# Autodesk Inventor assembly: ROBOT_FISH_2
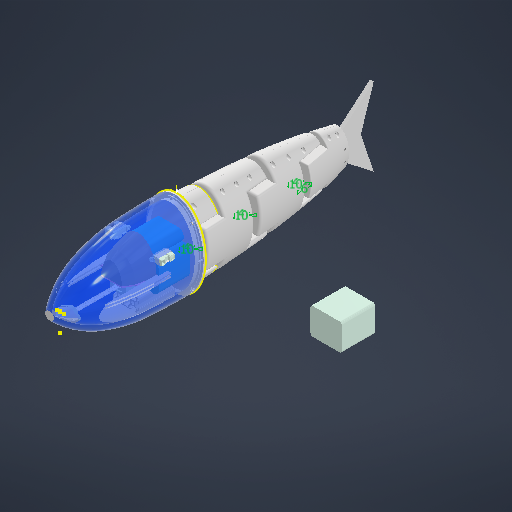
[picture p0: Inventor's stored thumbnail of the model, 512x512]
Saved by Autodesk Inventor 2027 (Build 310192060, 192F)
## iProperties
Created: 2026-04-03
Part Number: ROBOT_FISH_2
Document SubType Name: Assembly
Designer: thita
Author: thita
## Documents named in this file (19)
- D:\Year2\đồ án tốt nghịp\1\Workgroups\NotInProject\ROBOT_FISH_2.iam
- D:\Year2\đồ án tốt nghịp\1\Workgroups\NotInProject\Solid10.ipt
- D:\Year2\đồ án tốt nghịp\1\Workgroups\NotInProject\Solid12.ipt
- D:\Year2\đồ án tốt nghịp\1\Workgroups\NotInProject\Solid14.ipt
- D:\Year2\đồ án tốt nghịp\1\Workgroups\NotInProject\Hop_co_servo.iam
- D:\Year2\đồ án tốt nghịp\1\Workgroups\NotInProject\truc_khop_1_MIR.ipt
- D:\Year2\đồ án tốt nghịp\1\Workgroups\NotInProject\truc_khop2_MIR.ipt
- D:\Year2\đồ án tốt nghịp\1\Workgroups\NotInProject\truc_khop_3_MIR.ipt
- D:\Year2\đồ án tốt nghịp\1\Workgroups\NotInProject\NotInProject\NAP.ipt
- D:\Year2\đồ án tốt nghịp\1\Workgroups\NotInProject\Solid14_MIR6.ipt
- D:\Year2\đồ án tốt nghịp\1\Workgroups\NotInProject\Solid12_MIR8.ipt
- D:\Year2\đồ án tốt nghịp\1\Workgroups\NotInProject\Solid10_MIR6.ipt
- D:\Year2\đồ án tốt nghịp\1\Workgroups\NotInProject\Servo-9imod-DS35MG-180.ipt
- D:\Year2\đồ án tốt nghịp\1\Workgroups\NotInProject\Truc_khop_new_1.ipt
- D:\Year2\đồ án tốt nghịp\1\Workgroups\NotInProject\Truc_khop_new_2.ipt
- D:\Year2\đồ án tốt nghịp\1\Workgroups\NotInProject\Truc_khop_new_3.ipt
- D:\Year2\đồ án tốt nghịp\1\Workgroups\NotInProject\CPB RACING BEARING (6001-2RSH) v3.ipt
- D:\Year2\đồ án tốt nghịp\1\Workgroups\NotInProject\tail.ipt
- D:\Year2\đồ án tốt nghịp\1\Workgroups\NotInProject\Assembly1_stp.iam
## Components (24 placed, 18 different names)
1. Solid10:2 — Rigid:24, Rigid:32, Rigid:42
2. Solid12:3 — Rigid:23, Rigid:30, Rigid:31, Rotational:9, Rigid:33
3. Solid14:3 — Rigid:38, Rigid:39, Rigid:40
4. truc_khop_1_MIR:3 — Rotational:11
5. truc_khop2_MIR:3 — Rigid:39
6. truc_khop_3_MIR:3 — Rigid:31, Rotational:8
7. NAP:1 — Rigid:20, Rigid:41
8. Solid14_MIR6:1 — Rigid:35
9. Solid12_MIR8:1 — Rigid:33
10. Solid10_MIR6:1 — Rigid:32
11. Truc_khop_new_1:1 — Rigid:20, Rotational:10
12. Truc_khop_new_2:1 — Rigid:30, Rotational:13
13. Truc_khop_new_3:1 — Rigid:40, Rotational:12
14. Hop_co_servo:11 [sub-assembly] — Rigid:23, Rigid:25
15. Hop_co_servo:12 [sub-assembly] — Rigid:24, Rigid:26
16. Servo-9imod-DS35MG-180:2 — Rigid:25, Rotational:12
17. Servo-9imod-DS35MG-180:3 — Rigid:26, Rotational:13
18. CPB RACING BEARING (6001-2RSH) v3:1 — Rotational:11
19. CPB RACING BEARING (6001-2RSH) v3:3 — Rotational:8
20. CPB RACING BEARING (6001-2RSH) v3:4 — Rotational:9
21. Hop_co_servo:13 [sub-assembly] — Rigid:35, Rigid:37, Rigid:38
22. Servo-9imod-DS35MG-180:4 — Rotational:10, Rigid:37
23. tail:1 — Rigid:42
24. Assembly1_stp:1 [sub-assembly] — Rigid:41
## Relationships (22: WeldJoint 16, RevoluteJoint 6)
- Rigid:20 [WeldJoint]: NAP:1 ↔ Truc_khop_new_1:1
- Rigid:23 [WeldJoint]: Solid12:3 ↔ Hop_co_servo:11
- Rigid:24 [WeldJoint]: Solid10:2 ↔ Hop_co_servo:12
- Rigid:25 [WeldJoint]: Hop_co_servo:11 ↔ Servo-9imod-DS35MG-180:2
- Rigid:26 [WeldJoint]: Hop_co_servo:12 ↔ Servo-9imod-DS35MG-180:3
- Rigid:30 [WeldJoint]: Solid12:3 ↔ Truc_khop_new_2:1
- Rigid:31 [WeldJoint]: Solid12:3 ↔ truc_khop_3_MIR:3
- Rotational:8 [RevoluteJoint]: truc_khop_3_MIR:3 ↔ CPB RACING BEARING (6001-2RSH) v3:3
- Rotational:9 [RevoluteJoint]: Solid12:3 ↔ CPB RACING BEARING (6001-2RSH) v3:4
- Rigid:32 [WeldJoint]: Solid10:2 ↔ Solid10_MIR6:1
- Rigid:33 [WeldJoint]: Solid12:3 ↔ Solid12_MIR8:1
- Rigid:35 [WeldJoint]: Solid14_MIR6:1 ↔ Hop_co_servo:13
- Rotational:10 [RevoluteJoint] (0.257 mm): Truc_khop_new_1:1 ↔ Servo-9imod-DS35MG-180:4
- Rigid:37 [WeldJoint]: Hop_co_servo:13 ↔ Servo-9imod-DS35MG-180:4
- Rigid:38 [WeldJoint]: Solid14:3 ↔ Hop_co_servo:13
- Rotational:11 [RevoluteJoint]: truc_khop_1_MIR:3 ↔ CPB RACING BEARING (6001-2RSH) v3:1
- Rigid:39 [WeldJoint]: Solid14:3 ↔ truc_khop2_MIR:3
- Rigid:40 [WeldJoint]: Solid14:3 ↔ Truc_khop_new_3:1
- Rotational:12 [RevoluteJoint]: Truc_khop_new_3:1 ↔ Servo-9imod-DS35MG-180:2
- Rotational:13 [RevoluteJoint] (0.65 mm): Truc_khop_new_2:1 ↔ Servo-9imod-DS35MG-180:3
- Rigid:41 [WeldJoint]: NAP:1 ↔ Assembly1_stp:1
- Rigid:42 [WeldJoint]: Solid10:2 ↔ tail:1
